# Autodesk Inventor assembly: Gatevalve_70_pneumatic
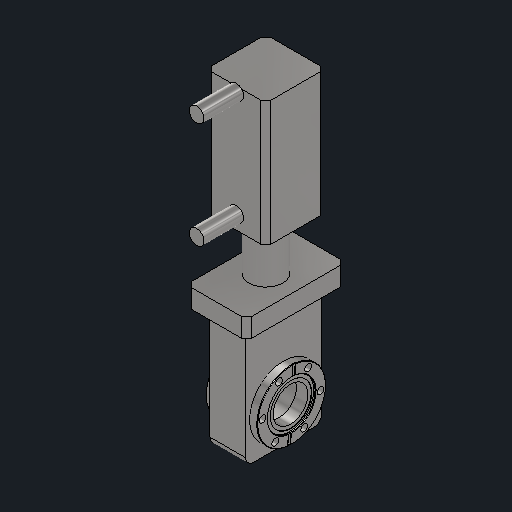
[picture p0: Inventor's stored thumbnail of the model, 512x512]
Saved by Autodesk Inventor 2027.1 (Build 311270010, 270A)
## iProperties
Created: 2022-11-16
Part Number: Gatevalve_70_pneumatic
Document SubType Name: Assembly
Designer: kuzmin
Author: kuzmin
## Documents named in this file (3)
- C:\Users\queezz\Dropbox\Drawings\pihti-cad\Miura-membrane-experiments\Miura-Gatevalve_70_pneumatic.iam
- C:\Users\queezz\Dropbox\Drawings\pihti-cad\Miura-membrane-experiments\Gatevalve_70_pneumatic.ipt
- C:\Users\queezz\Dropbox\Drawings\pihti-cad\Miura-membrane-experiments\cf70_hole_gv.ipt
## Components (3 placed, 2 different names)
1. Gatevalve_70_pneumatic:1 — Mate:1, Mate:2, Flush:1, Flush:2
2. cf70_hole_gv:1 — Mate:1, Flush:1
3. cf70_hole_gv:2 — Mate:2, Flush:2
## Relationships (4: Mate 2, Flush 2)
- Mate:1: Gatevalve_70_pneumatic:1 ↔ cf70_hole_gv:1
- Mate:2: Gatevalve_70_pneumatic:1 ↔ cf70_hole_gv:2
- Flush:1 (-8 mm): Gatevalve_70_pneumatic:1 ↔ cf70_hole_gv:1
- Flush:2 (-8 mm): Gatevalve_70_pneumatic:1 ↔ cf70_hole_gv:2
